# Autodesk Inventor assembly: Servo_Hip_Assembly
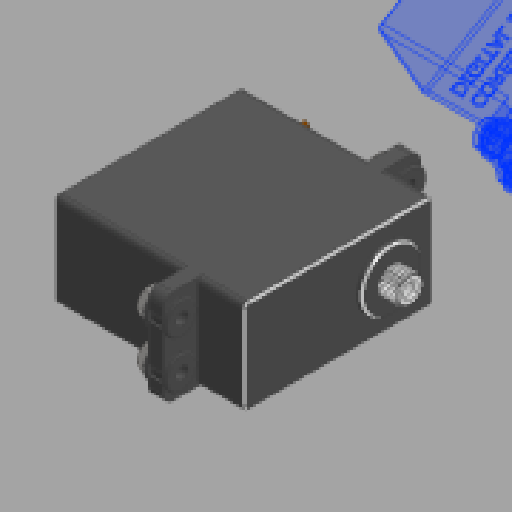
[picture p0: Inventor's stored thumbnail of the model, 512x512]
Saved by Autodesk Inventor 2025 (Build 290162000, 162)
## iProperties
Created: 2024-11-15
Part Number: Servo_Hip_Assembly
Document SubType Name: Assembly
Designer: OSB
Mass: 82 g
Surface Area: 85.8393 cm^2
Volume: 33.8017 cm^3
Density: 2.42591 g/cm^3
Sending System: Autodesk Inventor 2021
Preprocessor: unknown
Minimum Resolution: 0.01
Sent Units: Millimeter
Translation Standard: IGES 5.3
Model Creation Time: 2020-07-07
Title: S500 Frame
Author: OSB
## Documents named in this file (4)
- C:\Users\OSB\Desktop\SB\1.Projects\캡스톤 디자인(2)_Paper\Modeling\Implementation_Design\Ver_004_mass_update\Servo_Hip_Assembly.iam
- C:\Users\OSB\Desktop\SB\1.Projects\캡스톤 디자인(2)_Paper\Modeling\Implementation_Design\Ver_004_mass_update\Servo_Hip_DSC55MG.ipt
- C:\Users\OSB\Desktop\SB\1.Projects\캡스톤 디자인(2)_Paper\Modeling\Implementation_Design\Ver_004_mass_update\Grommet_HipServo.ipt
- C:\Users\OSB\Documents\Inventor\Content Center Files\R2025\ko-KR\KS B 1012  S2 F\KS B 1012 - M 2.5(1).ipt
## Components (9 placed, 3 different names)
1. Servo_Hip_DSC55MG:1 — 강체:1, 강체:2, 강체:3, 강체:4
2. Grommet_HipServo:1 — 강체:3, 삽입:2
3. Grommet_HipServo:2 — 강체:2, 삽입:4
4. Grommet_HipServo:3 — 강체:1, 삽입:3
5. Grommet_HipServo:4 — 강체:4, 삽입:1
6. KS B 1012 스타일 2 다듬질 - 미터 M 2.5:1 — 삽입:1
7. KS B 1012 스타일 2 다듬질 - 미터 M 2.5:2 — 삽입:2
8. KS B 1012 스타일 2 다듬질 - 미터 M 2.5:3 — 삽입:3
9. KS B 1012 스타일 2 다듬질 - 미터 M 2.5:4 — 삽입:4
## Relationships (8: WeldJoint 4, Insert 4)
- 강체:1 [WeldJoint]: Servo_Hip_DSC55MG:1 ↔ Grommet_HipServo:3
- 강체:2 [WeldJoint]: Servo_Hip_DSC55MG:1 ↔ Grommet_HipServo:2
- 강체:3 [WeldJoint]: Servo_Hip_DSC55MG:1 ↔ Grommet_HipServo:1
- 강체:4 [WeldJoint]: Servo_Hip_DSC55MG:1 ↔ Grommet_HipServo:4
- 삽입:1 [Insert]: Grommet_HipServo:4 ↔ KS B 1012 스타일 2 다듬질 - 미터 M 2.5:1
- 삽입:2 [Insert]: Grommet_HipServo:1 ↔ KS B 1012 스타일 2 다듬질 - 미터 M 2.5:2
- 삽입:3 [Insert]: Grommet_HipServo:3 ↔ KS B 1012 스타일 2 다듬질 - 미터 M 2.5:3
- 삽입:4 [Insert]: Grommet_HipServo:2 ↔ KS B 1012 스타일 2 다듬질 - 미터 M 2.5:4
